# Autodesk Inventor assembly: 1133 FP-800x1800x47
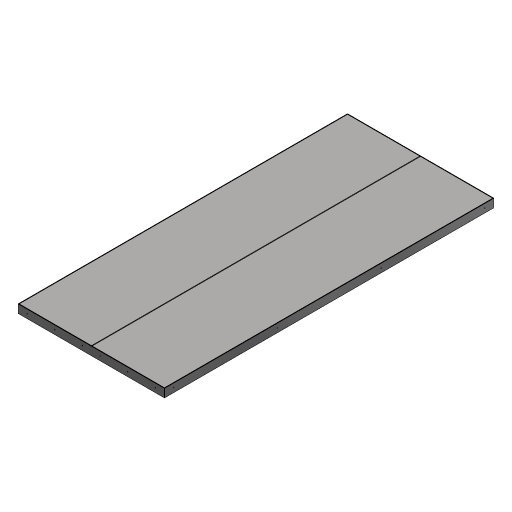
[picture p0: Inventor's stored thumbnail of the model, 512x512]
Saved by Autodesk Inventor 2024.3 (Build 283343000, 343)
## iProperties
RuleStatus: InUse
Created: 2019-06-24
Part Number: 1133 FP-800x1800x47
Material: Generisch
Document SubType Name: Assembly
Designer: MK
Mass: 27437.8 g
Surface Area: 70062.5 cm^2
Volume: 3495.27 cm^3
Density: 7.85 g/cm^3
Description: Tür-Paneel
InventorSizerSetup: FP 2
Author: MK
## Documents named in this file (3)
- C:\Users\la\Documents\GitHub\Inventor_Sizer\C# Version\masters\FP\2T\1133 FP-800x1800x47.iam
- C:\Users\la\Documents\GitHub\Inventor_Sizer\C# Version\masters\FP\2T\1133 800x1800x47-Au.ipt
- C:\Users\la\Documents\GitHub\Inventor_Sizer\C# Version\masters\FP\2T\1133 800x1800x47-In.ipt
## Components (3 placed, 2 different names)
1. 1133 800x1800x47-Au:1 — Mate:6, Mate:7, Mate:8
2. 1133 800x1800x47-In:1 — Mate:6, Mate:7, Mate:8
3. 1133 800x1800x47-In:2
## Component patterns: (2 elements, first: 1133 800x1800x47-In:1)
## Relationships (3: Mate 3)
- Mate:6: 1133 800x1800x47-Au:1 ↔ 1133 800x1800x47-In:1
- Mate:7 (0.5 mm): 1133 800x1800x47-Au:1 ↔ 1133 800x1800x47-In:1
- Mate:8 (0.5 mm): 1133 800x1800x47-Au:1 ↔ 1133 800x1800x47-In:1
## Named parameters: Clearance = 0.5 mm, Width = 800 mm, InSplit = 2, InWidth = 398.5 mm
